# Autodesk Inventor assembly: montagem_omnicare
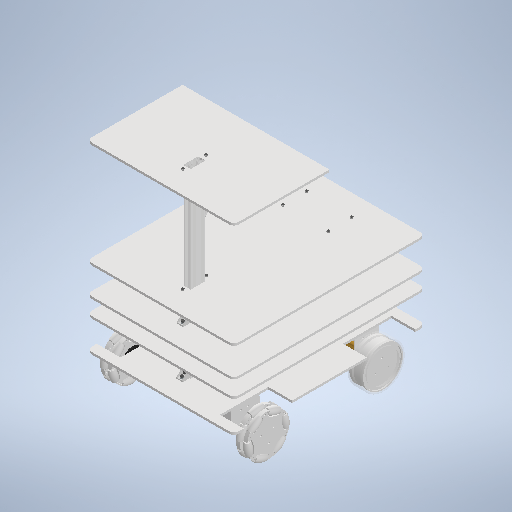
[picture p0: Inventor's stored thumbnail of the model, 512x512]
Saved by Autodesk Inventor 2025.2 (Build 292293000, 293)
## iProperties
Created: 2026-05-19
Part Number: montagem_omnicare
Document SubType Name: Assembly
Designer: joaoc
Author: joaoc
## iProperties of the stored document Chapa motor.ipt
Created: 2025-01-07
Part Number: Chapa motor
Material: Aluminum
Document SubType Name: Modeling
Designer: Cliente
Mass: 34.2734 g
Surface Area: 97.6448 cm^2
Volume: 12.6938 cm^3
Density: 2.7 g/cm^3
Appearance: Default
Sending System: Autodesk Inventor 2026
Author: Cliente
## iProperties of the stored document Perfil Estrutural em Alumínio 20x40 V-Slot - Canal 6 (180mm - 45º).ipt
Created: 2025-08-09
Part Number: Perfil Estrutural em Alumínio 20x40 V-Slot - Canal 6 (180mm - 45°)
Material: Aluminum 6061
Document SubType Name: Modeling
Designer: Cliente
Mass: 105 g
Surface Area: 421.207 cm^2
Volume: 41.3159 cm^3
Density: 2.5414 g/cm^3
Appearance: Default
Sending System: Autodesk Inventor 2026
Author: Cliente
## iProperties of the stored document Porca Sextavada DIN 934 - M4 - 8.ipt
Created: 2025-07-13
Part Number: Porca Sextavada DIN 934 - M4 - 8
Material: Stainless Steel
Document SubType Name: Modeling
Designer: Cliente
Mass: 0.824132 g
Surface Area: 1.70892 cm^2
Volume: 0.103016 cm^3
Density: 8 g/cm^3
Appearance: Default
Sending System: Autodesk Inventor 2026
Author: Cliente
## iProperties of the stored document Cantoneira em alumínio 20X20X17.ipt
Created: 2025-07-09
Part Number: Cantoneira em Alumínio 20X20X17
Material: Aluminum
Document SubType Name: Modeling
Designer: Cliente
Mass: 5.97516 g
Surface Area: 21.2782 cm^2
Volume: 2.21302 cm^3
Density: 2.7 g/cm^3
Appearance: Default
Sending System: Autodesk Inventor 2026
Author: Cliente
## iProperties of the stored document Parafuso Allen Cabeça Cilíndrica DIN 912 - M4 - 12.9_1.ipt
Created: 2025-07-13
Part Number: Parafuso Allen Cabeça Cilíndrica DIN 912 - M4 X 16 - 12.9
Material: Steel, Carbon
Document SubType Name: Modeling
Designer: Cliente
Mass: 2.27289 g
Surface Area: 4.7818 cm^2
Volume: 0.28954 cm^3
Density: 7.85 g/cm^3
Appearance: Default
Sending System: Autodesk Inventor 2026
Author: Cliente
## iProperties of the stored document Trava estrutura suporte manipulador - direita.ipt
Created: 2025-10-07
Part Number: Trava estrutura suporte manipulador - direita
Material: ABS Plastic
Document SubType Name: Modeling
Designer: Cliente
Mass: 28.5709 g
Surface Area: 125.242 cm^2
Volume: 26.9537 cm^3
Density: 1.06 g/cm^3
Appearance: Default
Sending System: Autodesk Inventor 2026
Author: Cliente
## iProperties of the stored document Cantoneira montada perfil x prateleira.iam
Created: 2025-07-09
Part Number: Cantoneira montada perfil x prateleira
Document SubType Name: Assembly
Designer: Cliente
Mass: 12.8728 g
Surface Area: 37.7866 cm^2
Volume: 3.08973 cm^3
Density: 4.16631 g/cm^3
Sending System: Autodesk Inventor 2026
Author: Cliente
## iProperties of the stored document Arruela de Pressão DIN 127 - B4.ipt
Created: 2025-07-13
Part Number: Arruela de Pressão DIN 127 - B4
Material: Steel, Carbon
Document SubType Name: Modeling
Designer: Cliente
Mass: 0.190332 g
Surface Area: 0.874611 cm^2
Volume: 0.0242461 cm^3
Density: 7.85 g/cm^3
Appearance: Default
Sending System: Autodesk Inventor 2026
Author: Cliente
## iProperties of the stored document Trava estrutura suporte manipulador - esquerda.ipt
Created: 2025-10-07
Part Number: Trava estrutura suporte manipulador - esquerda
Material: ABS Plastic
Document SubType Name: Modeling
Designer: Cliente
Mass: 28.5709 g
Surface Area: 125.242 cm^2
Volume: 26.9537 cm^3
Density: 1.06 g/cm^3
Appearance: Default
Sending System: Autodesk Inventor 2026
Author: Cliente
## iProperties of the stored document Calço motor Pittman.iam
Created: 2025-01-15
Part Number: Calço motor Pittman
Document SubType Name: Assembly
Designer: Cliente
Mass: 37.2182 g
Surface Area: 150.978 cm^2
Volume: 26.1282 cm^3
Density: 1.42444 g/cm^3
Sending System: Autodesk Inventor 2026
Author: Cliente
## iProperties of the stored document Perfil Estrutural em Alumínio 20x40 V-Slot - Canal 6 (210mm).ipt
Created: 2025-08-09
Part Number: Perfil Estrutural em Alumínio 20x40 V-Slot - Canal 6 (210mm)
Material: Aluminum 6061
Document SubType Name: Modeling
Designer: Cliente
Mass: 157.5 g
Surface Area: 625.192 cm^2
Volume: 61.9738 cm^3
Density: 2.5414 g/cm^3
Appearance: Default
Sending System: Autodesk Inventor 2026
Author: Cliente
## iProperties of the stored document Perfil Estrutural em Alumínio 20x40 V-Slot - Canal 6 (500mm).ipt
Created: 2025-08-09
Part Number: Perfil Estrutural em Alumínio 20x40 V-Slot - Canal 6 (500mm)
Material: Aluminum 6061
Document SubType Name: Modeling
Designer: Cliente
Mass: 375 g
Surface Area: 1480.4 cm^2
Volume: 147.557 cm^3
Density: 2.5414 g/cm^3
Appearance: Default
Sending System: Autodesk Inventor 2026
Author: Cliente
## iProperties of the stored document Calço motor Pittman.ipt
Created: 2025-01-07
Part Number: Calço motor Pittman
Material: ABS Plastic
Document SubType Name: Modeling
Designer: Cliente
Mass: 23.36 g
Surface Area: 117.987 cm^2
Volume: 24.3629 cm^3
Density: 1.06 g/cm^3
Appearance: Default
Sending System: Autodesk Inventor 2026
Author: Cliente
## iProperties of the stored document Parafuso Allen Cabeça Cilíndrica DIN 912 - M4 - 12.9.ipt
Created: 2025-07-13
Part Number: Parafuso Allen Cabeça Cilíndrica DIN 912 - M4 X 10 - 12.9
Material: Steel, Carbon
Document SubType Name: Modeling
Designer: Cliente
Mass: 1.80147 g
Surface Area: 3.65298 cm^2
Volume: 0.229486 cm^3
Density: 7.85 g/cm^3
Appearance: Default
Sending System: Autodesk Inventor 2026
Author: Cliente
## iProperties of the stored document Porca martelo M4 canal 6.ipt
Created: 2025-02-01
Part Number: Porca martelo M4 canal 6
Material: Steel, Galvanized
Document SubType Name: Modeling
Designer: Cliente
Mass: 1.0124 g
Surface Area: 2.07329 cm^2
Volume: 0.128969 cm^3
Density: 7.85 g/cm^3
Appearance: Default
Sending System: Autodesk Inventor 2026
Author: Cliente
## iProperties of the stored document Arruela Lisa DIN 125 - B4 - 300 HV.ipt
Created: 2025-07-13
Part Number: Arruela Lisa DIN 125 - B4 - 300 HV
Material: Steel, Carbon
Document SubType Name: Modeling
Designer: Cliente
Mass: 0.303016 g
Surface Area: 1.27111 cm^2
Volume: 0.0386007 cm^3
Density: 7.85 g/cm^3
Appearance: Default
Sending System: Autodesk Inventor 2026
Author: Cliente
## Documents named in this file (39)
- C:\Users\joaoc\Documents\montagem omnicare final\montagem_omnicare.iam
- C:\Users\joaoc\Documents\montagem omnicare final\chapeado MDF\base.ipt
- **C:\Users\joaoc\Documents\montagem omnicare final\montagem_omnicare.iam*LocalDocs*xAaaaqhbaAaaaaaaaAaaaa1vsCe*Perfil Estrutural em Alumínio 20x40 V-Slot - Canal 6 (500mm).ipt
- C:\Users\joaoc\Documents\montagem omnicare final\chapeado MDF\meio.ipt
- C:\Users\joaoc\Documents\montagem omnicare final\chapeado MDF\topo.ipt
- **C:\Users\joaoc\Documents\montagem omnicare final\montagem_omnicare.iam*LocalDocs*xAaaaazdaAaaaaaaaAaaaqctoEa*Perfil Estrutural em Alumínio 20x40 V-Slot - Canal 6 (210mm).ipt
- **C:\Users\joaoc\Documents\montagem omnicare final\montagem_omnicare.iam*LocalDocs*xAaaaahbaAaaaaaaaAaaaat5aXe*Cantoneira montada perfil x prateleira.iam
- C:\Users\joaoc\Documents\montagem omnicare final\Motor\Motor Pittman GM9413G937-R5.ipt
- **C:\Users\joaoc\Documents\montagem omnicare final\montagem_omnicare.iam*LocalDocs*xAaaaqdbaAaaaaaaaAaaaackpWc*Calço motor Pittman.iam
- **C:\Users\joaoc\Documents\montagem omnicare final\montagem_omnicare.iam*LocalDocs*xAaaaafaaAaaaaaaaAaaaae4iNe*Chapa motor.ipt
- C:\Users\joaoc\Documents\montagem omnicare final\Perfil de alumínio\Perfil de alumínio.ipt
- C:\Users\joaoc\Documents\montagem omnicare final\montagem roda omni (adaptada).iam
- **C:\Users\joaoc\Documents\montagem omnicare final\montagem_omnicare.iam*LocalDocs*xAaaaa2daAaaaaaaaAaaaaxveNg*Perfil Estrutural em Alumínio 20x40 V-Slot - Canal 6 (180mm - 45º).ipt
- **C:\Users\joaoc\Documents\montagem omnicare final\montagem_omnicare.iam*LocalDocs*xAaaaqibaAaaaaaaaAaaaqlyu4b*Trava estrutura suporte manipulador - esquerda.ipt
- **C:\Users\joaoc\Documents\montagem omnicare final\montagem_omnicare.iam*LocalDocs*xAaaaakdaAaaaaaaaAaaaqeo1Oa*Trava estrutura suporte manipulador - direita.ipt
- C:\Users\joaoc\Documents\montagem omnicare final\roda dif\roda diferencial.iam
- C:\Users\joaoc\Documents\montagem omnicare final\Fixação\Cantoneira montada perfil x prateleira.iam
- C:\Users\joaoc\Documents\montagem omnicare final\Fixação\Arruela de Pressão DIN 127 - B4.ipt
- C:\Users\joaoc\Documents\montagem omnicare final\Fixação\Arruela Lisa DIN 125 - B4 - 300 HV.ipt
- C:\Users\joaoc\Documents\montagem omnicare final\Fixação\Cantoneira em alumínio 20X20X17.ipt
- C:\Users\joaoc\Documents\montagem omnicare final\Fixação\Parafuso Allen Cabeça Cilíndrica DIN 912 - M4 - 12.9.ipt
- C:\Users\joaoc\Documents\montagem omnicare final\Fixação\Porca martelo M4 canal 6.ipt
- C:\Users\joaoc\Documents\montagem omnicare final\Fixação\Porca Sextavada DIN 934 - M4 - 8.ipt
- C:\Users\joaoc\Documents\montagem omnicare final\Perfil de alumínio\Perfil Estrutural em Alumínio 20x40 V-Slot - Canal 6 (500mm).ipt
- C:\Users\joaoc\Documents\montagem omnicare final\Perfil de alumínio\Perfil Estrutural em Alumínio 20x40 V-Slot - Canal 6 (210mm).ipt
- C:\Users\joaoc\Documents\montagem omnicare final\Motor\Calço motor Pittman.iam
- C:\Users\joaoc\Documents\montagem omnicare final\Impresso\Calço motor Pittman.ipt
- C:\Users\joaoc\Documents\montagem omnicare final\Motor\Chapa motor.ipt
- C:\Users\joaoc\Documents\montagem omnicare final\Perfil de alumínio\Perfil Estrutural em Alumínio 20x40 V-Slot - Canal 6 (180mm - 45º).ipt
- C:\Users\joaoc\Documents\montagem omnicare final\Impresso\Trava estrutura suporte manipulador - esquerda.ipt
- C:\Users\joaoc\Documents\montagem omnicare final\Impresso\Trava estrutura suporte manipulador - direita.ipt
- **C:\Users\joaoc\Documents\montagem omnicare final\montagem_omnicare.iam*LocalDocs*xAaaaa2aaAaaaaaaaAaaaq3xg0g*Porca Sextavada DIN 934 - M4 - 8.ipt
- **C:\Users\joaoc\Documents\montagem omnicare final\montagem_omnicare.iam*LocalDocs*xAaaaadaaAaaaaaaaAaaaqdxfMh*Cantoneira em alumínio 20X20X17.ipt
- **C:\Users\joaoc\Documents\montagem omnicare final\montagem_omnicare.iam*LocalDocs*xAaaaaxdaAaaaaaaaAaaaqaodOc*Parafuso Allen Cabeça Cilíndrica DIN 912 - M4 - 12.9_1.ipt
- **C:\Users\joaoc\Documents\montagem omnicare final\montagem_omnicare.iam*LocalDocs*xAaaaqxcaAaaaaaaaAaaaah4bBa*Arruela Lisa DIN 125 - B4 - 300 HV.ipt
- **C:\Users\joaoc\Documents\montagem omnicare final\montagem_omnicare.iam*LocalDocs*xAaaaaubaAaaaaaaaAaaaq04cSb*Arruela de Pressão DIN 127 - B4.ipt
- **C:\Users\joaoc\Documents\montagem omnicare final\montagem_omnicare.iam*LocalDocs*xAaaaqjcaAaaaaaaaAaaaawm1Eh*Parafuso Allen Cabeça Cilíndrica DIN 912 - M4 - 12.9.ipt
- **C:\Users\joaoc\Documents\montagem omnicare final\montagem_omnicare.iam*LocalDocs*xAaaaqwaaAaaaaaaaAaaaqfjfZh*Porca martelo M4 canal 6.ipt
- **C:\Users\joaoc\Documents\montagem omnicare final\montagem_omnicare.iam*LocalDocs*xAaaaqkbaAaaaaaaaAaaaqhjdWh*Calço motor Pittman.ipt
## Components (45 placed, 15 different names)
1. base:1 — Mate:25, Mate:33, Mate:35, Mate:46, Mate:47, Mate:49, Mate:50, Mate:54, Slider:8, Slider:9, Mate:73, Mate:74, Slider:11, Mate:108, Mate:109, Mate:110, Mate:111, Mate:112, Mate:162, Mate:163, Mate:164, Mate:165, Mate:166, Mate:167
2. Perfil Estrutural (500):1 — Slider:11, Mate:108, Mate:117, Mate:118, Mate:119, Mate:120, Mate:121, Mate:122, Mate:123, Mate:124, Mate:125, Mate:126, Mate:127, Mate:128, Mate:129, Mate:130, Mate:131, Mate:132, Slider:12, Mate:168, Mate:171, Mate:172, Mate:173, Mate:174, Mate:175, Mate:177
3. Perfil Estrutural (210mm):3 — Slider:8, Mate:73, Slider:10, Mate:75, Mate:78, Mate:79, Mate:80, Mate:81, Mate:88, Mate:89, Mate:90, Mate:91, Mate:92, Mate:93, Mate:94, Mate:95, Mate:100, Mate:101, Mate:102, Mate:103
4. Perfil Estrutural (210mm):4 — Slider:9, Mate:74, Mate:76, Mate:77, Mate:82, Mate:83, Mate:84, Mate:85, Mate:86, Mate:87, Mate:96, Mate:97, Mate:98, Mate:99, Mate:104, Mate:105, Mate:106, Mate:107
5. meio:1 — Mate:65, Mate:66, Mate:67, Mate:68, Mate:69, Mate:70, Mate:71, Mate:72, Slider:10, Mate:75, Mate:113, Mate:114, Mate:115, Mate:116
6. topo:1 — Slider:12, Mate:168, Mate:169, Mate:170, Mate:176, Mate:179, Mate:183
7. Perfil de alumínio:1 — Mate:149, Mate:150, Mate:151, Mate:152, Mate:155, Mate:156, Mate:157, Mate:160, Mate:161, Mate:163, Mate:164
8. montagem roda omni (adaptada):1 [sub-assembly] — Mate:165, Mate:166, Mate:167
9. roda diferencial:1 [sub-assembly] — Insert:1
10. roda diferencial:2 [sub-assembly] — Insert:2
11. Perfil Estrutural em Alumínio 20x40 V-Slot - Canal 6 (180mm - 45º):1 — Mate:175, Mate:176, Mate:177, Mate:178, Mate:182, Mate:184, Mate:185
12. Trava estrutura suporte manipulador - esquerda:1 — Mate:178, Mate:179, Mate:182
13. Trava estrutura suporte manipulador - direita:1 — Mate:183, Mate:184, Mate:185
14. Cantoneira montada perfil x prateleira:29 [sub-assembly] — Mate:170, Mate:171, Mate:173
15. Cantoneira montada perfil x prateleira:30 [sub-assembly] — Mate:169, Mate:172, Mate:174
16. Chapa motor:1 — Mate:140, Mate:141, Mate:142, Mate:152, Mate:156, Mate:157, Mate:160
17. Calço motor Pittman:1 [sub-assembly] — Mate:143, Mate:144, Mate:161
18. Motor Pittman GM9413G937-R5:1 — Mate:140, Mate:141, Mate:142, Mate:143, Mate:144, Insert:1
19. Motor Pittman GM9413G937-R5:2 — Mate:145, Mate:146, Mate:147, Mate:153, Mate:154, Insert:2
20. Calço motor Pittman:2 [sub-assembly] — Mate:153, Mate:154, Mate:155
21. Chapa motor:2 — Mate:145, Mate:146, Mate:147, Mate:149, Mate:150, Mate:151, Mate:162
22. Cantoneira montada perfil x prateleira:27 [sub-assembly] — Mate:110, Mate:118, Mate:126
23. Cantoneira montada perfil x prateleira:28 [sub-assembly] — Mate:109, Mate:117, Mate:125
24. Cantoneira montada perfil x prateleira:1 [sub-assembly] — Mate:54, Mate:90, Mate:91
25. Cantoneira montada perfil x prateleira:2 [sub-assembly] — Mate:25, Mate:86, Mate:87
26. Cantoneira montada perfil x prateleira:3 [sub-assembly] — Mate:33, Mate:84, Mate:85
27. Cantoneira montada perfil x prateleira:4 [sub-assembly] — Mate:35, Mate:88, Mate:89
28. Cantoneira montada perfil x prateleira:25 [sub-assembly] — Mate:112, Mate:121, Mate:127
29. Cantoneira montada perfil x prateleira:26 [sub-assembly] — Mate:111, Mate:122, Mate:128
30. Cantoneira montada perfil x prateleira:9 [sub-assembly] — Mate:50, Mate:78, Mate:79
31. Cantoneira montada perfil x prateleira:10 [sub-assembly] — Mate:47, Mate:82, Mate:83
32. Cantoneira montada perfil x prateleira:11 [sub-assembly] — Mate:46, Mate:80, Mate:81
33. Cantoneira montada perfil x prateleira:12 [sub-assembly] — Mate:49, Mate:76, Mate:77
34. Cantoneira montada perfil x prateleira:23 [sub-assembly] — Mate:114, Mate:120, Mate:131
35. Cantoneira montada perfil x prateleira:24 [sub-assembly] — Mate:113, Mate:119, Mate:129
36. Cantoneira montada perfil x prateleira:13 [sub-assembly] — Mate:65, Mate:92, Mate:93
37. Cantoneira montada perfil x prateleira:14 [sub-assembly] — Mate:67, Mate:94, Mate:95
38. Cantoneira montada perfil x prateleira:15 [sub-assembly] — Mate:66, Mate:97, Mate:98
39. Cantoneira montada perfil x prateleira:16 [sub-assembly] — Mate:68, Mate:96, Mate:99
40. Cantoneira montada perfil x prateleira:21 [sub-assembly] — Mate:116, Mate:123, Mate:130
41. Cantoneira montada perfil x prateleira:22 [sub-assembly] — Mate:115, Mate:124, Mate:132
42. Cantoneira montada perfil x prateleira:17 [sub-assembly] — Mate:69, Mate:104, Mate:105
43. Cantoneira montada perfil x prateleira:18 [sub-assembly] — Mate:70, Mate:102, Mate:103
44. Cantoneira montada perfil x prateleira:19 [sub-assembly] — Mate:72, Mate:106, Mate:107
45. Cantoneira montada perfil x prateleira:20 [sub-assembly] — Mate:71, Mate:100, Mate:101
## Relationships (124: Mate 117, TranslationJoint 5, Insert 2)
- Mate:25: base:1 ↔ Cantoneira montada perfil x prateleira:2
- Mate:33: base:1 ↔ Cantoneira montada perfil x prateleira:3
- Mate:35: base:1 ↔ Cantoneira montada perfil x prateleira:4
- Mate:46: base:1 ↔ Cantoneira montada perfil x prateleira:11
- Mate:47: base:1 ↔ Cantoneira montada perfil x prateleira:10
- Mate:49: base:1 ↔ Cantoneira montada perfil x prateleira:12
- Mate:50: base:1 ↔ Cantoneira montada perfil x prateleira:9
- Mate:54: base:1 ↔ Cantoneira montada perfil x prateleira:1
- Mate:65: meio:1 ↔ Cantoneira montada perfil x prateleira:13
- Mate:66: meio:1 ↔ Cantoneira montada perfil x prateleira:15
- Mate:67: meio:1 ↔ Cantoneira montada perfil x prateleira:14
- Mate:68: meio:1 ↔ Cantoneira montada perfil x prateleira:16
- Mate:69: meio:1 ↔ Cantoneira montada perfil x prateleira:17
- Mate:70: meio:1 ↔ Cantoneira montada perfil x prateleira:18
- Mate:71: meio:1 ↔ Cantoneira montada perfil x prateleira:20
- Mate:72: meio:1 ↔ Cantoneira montada perfil x prateleira:19
- Slider:8 [TranslationJoint]: base:1 ↔ Perfil Estrutural (210mm):3
- Slider:9 [TranslationJoint]: base:1 ↔ Perfil Estrutural (210mm):4
- Mate:73: base:1 ↔ Perfil Estrutural (210mm):3
- Mate:74: base:1 ↔ Perfil Estrutural (210mm):4
- Slider:10 [TranslationJoint]: Perfil Estrutural (210mm):3 ↔ meio:1
- Mate:75: Perfil Estrutural (210mm):3 ↔ meio:1
- Mate:76: Perfil Estrutural (210mm):4 ↔ Cantoneira montada perfil x prateleira:12
- Mate:77: Perfil Estrutural (210mm):4 ↔ Cantoneira montada perfil x prateleira:12
- Mate:78: Perfil Estrutural (210mm):3 ↔ Cantoneira montada perfil x prateleira:9
- Mate:79: Perfil Estrutural (210mm):3 ↔ Cantoneira montada perfil x prateleira:9
- Mate:80: Perfil Estrutural (210mm):3 ↔ Cantoneira montada perfil x prateleira:11
- Mate:81: Perfil Estrutural (210mm):3 ↔ Cantoneira montada perfil x prateleira:11
- Mate:82: Perfil Estrutural (210mm):4 ↔ Cantoneira montada perfil x prateleira:10
- Mate:83: Perfil Estrutural (210mm):4 ↔ Cantoneira montada perfil x prateleira:10
- Mate:84: Perfil Estrutural (210mm):4 ↔ Cantoneira montada perfil x prateleira:3
- Mate:85: Perfil Estrutural (210mm):4 ↔ Cantoneira montada perfil x prateleira:3
- Mate:86: Perfil Estrutural (210mm):4 ↔ Cantoneira montada perfil x prateleira:2
- Mate:87: Perfil Estrutural (210mm):4 ↔ Cantoneira montada perfil x prateleira:2
- Mate:88: Perfil Estrutural (210mm):3 ↔ Cantoneira montada perfil x prateleira:4
- Mate:89: Perfil Estrutural (210mm):3 ↔ Cantoneira montada perfil x prateleira:4
- Mate:90: Perfil Estrutural (210mm):3 ↔ Cantoneira montada perfil x prateleira:1
- Mate:91: Perfil Estrutural (210mm):3 ↔ Cantoneira montada perfil x prateleira:1
- Mate:92: Perfil Estrutural (210mm):3 ↔ Cantoneira montada perfil x prateleira:13
- Mate:93: Perfil Estrutural (210mm):3 ↔ Cantoneira montada perfil x prateleira:13
- Mate:94: Perfil Estrutural (210mm):3 ↔ Cantoneira montada perfil x prateleira:14
- Mate:95: Perfil Estrutural (210mm):3 ↔ Cantoneira montada perfil x prateleira:14
- Mate:96: Perfil Estrutural (210mm):4 ↔ Cantoneira montada perfil x prateleira:16
- Mate:97: Perfil Estrutural (210mm):4 ↔ Cantoneira montada perfil x prateleira:15
- Mate:98: Perfil Estrutural (210mm):4 ↔ Cantoneira montada perfil x prateleira:15
- Mate:99: Perfil Estrutural (210mm):4 ↔ Cantoneira montada perfil x prateleira:16
- Mate:100: Perfil Estrutural (210mm):3 ↔ Cantoneira montada perfil x prateleira:20
- Mate:101: Perfil Estrutural (210mm):3 ↔ Cantoneira montada perfil x prateleira:20
- Mate:102: Perfil Estrutural (210mm):3 ↔ Cantoneira montada perfil x prateleira:18
- Mate:103: Perfil Estrutural (210mm):3 ↔ Cantoneira montada perfil x prateleira:18
- Mate:104: Perfil Estrutural (210mm):4 ↔ Cantoneira montada perfil x prateleira:17
- Mate:105: Perfil Estrutural (210mm):4 ↔ Cantoneira montada perfil x prateleira:17
- Mate:106: Perfil Estrutural (210mm):4 ↔ Cantoneira montada perfil x prateleira:19
- Mate:107: Perfil Estrutural (210mm):4 ↔ Cantoneira montada perfil x prateleira:19
- Slider:11 [TranslationJoint]: base:1 ↔ Perfil Estrutural (500):1
- Mate:108: base:1 ↔ Perfil Estrutural (500):1
- Mate:109: base:1 ↔ Cantoneira montada perfil x prateleira:28
- Mate:110: base:1 ↔ Cantoneira montada perfil x prateleira:27
- Mate:111: base:1 ↔ Cantoneira montada perfil x prateleira:26
- Mate:112: base:1 ↔ Cantoneira montada perfil x prateleira:25
- Mate:113: meio:1 ↔ Cantoneira montada perfil x prateleira:24
- Mate:114: meio:1 ↔ Cantoneira montada perfil x prateleira:23
- Mate:115: meio:1 ↔ Cantoneira montada perfil x prateleira:22
- Mate:116: meio:1 ↔ Cantoneira montada perfil x prateleira:21
- Mate:117: Perfil Estrutural (500):1 ↔ Cantoneira montada perfil x prateleira:28
- Mate:118: Perfil Estrutural (500):1 ↔ Cantoneira montada perfil x prateleira:27
- Mate:119: Perfil Estrutural (500):1 ↔ Cantoneira montada perfil x prateleira:24
- Mate:120: Perfil Estrutural (500):1 ↔ Cantoneira montada perfil x prateleira:23
- Mate:121: Perfil Estrutural (500):1 ↔ Cantoneira montada perfil x prateleira:25
- Mate:122: Perfil Estrutural (500):1 ↔ Cantoneira montada perfil x prateleira:26
- Mate:123: Perfil Estrutural (500):1 ↔ Cantoneira montada perfil x prateleira:21
- Mate:124: Perfil Estrutural (500):1 ↔ Cantoneira montada perfil x prateleira:22
- Mate:125: Perfil Estrutural (500):1 ↔ Cantoneira montada perfil x prateleira:28
- Mate:126: Perfil Estrutural (500):1 ↔ Cantoneira montada perfil x prateleira:27
- Mate:127: Perfil Estrutural (500):1 ↔ Cantoneira montada perfil x prateleira:25
- Mate:128: Perfil Estrutural (500):1 ↔ Cantoneira montada perfil x prateleira:26
- Mate:129: Perfil Estrutural (500):1 ↔ Cantoneira montada perfil x prateleira:24
- Mate:130: Perfil Estrutural (500):1 ↔ Cantoneira montada perfil x prateleira:21
- Mate:131: Perfil Estrutural (500):1 ↔ Cantoneira montada perfil x prateleira:23
- Mate:132: Perfil Estrutural (500):1 ↔ Cantoneira montada perfil x prateleira:22
- Mate:140: Chapa motor:1 ↔ Motor Pittman GM9413G937-R5:1
- Mate:141: Chapa motor:1 ↔ Motor Pittman GM9413G937-R5:1
- Mate:142: Chapa motor:1 ↔ Motor Pittman GM9413G937-R5:1
- Mate:143: Calço motor Pittman:1 ↔ Motor Pittman GM9413G937-R5:1
- Mate:144 (5 mm): Calço motor Pittman:1 ↔ Motor Pittman GM9413G937-R5:1
- Mate:145: Motor Pittman GM9413G937-R5:2 ↔ Chapa motor:2
- Mate:146: Motor Pittman GM9413G937-R5:2 ↔ Chapa motor:2
- Mate:147: Motor Pittman GM9413G937-R5:2 ↔ Chapa motor:2
- Mate:149: Perfil de alumínio:1 ↔ Chapa motor:2
- Mate:150: Perfil de alumínio:1 ↔ Chapa motor:2
- Mate:151: Perfil de alumínio:1 ↔ Chapa motor:2
- Mate:152: Perfil de alumínio:1 ↔ Chapa motor:1
- Mate:153: Motor Pittman GM9413G937-R5:2 ↔ Calço motor Pittman:2
- Mate:154: Motor Pittman GM9413G937-R5:2 ↔ Calço motor Pittman:2
- Mate:155: Perfil de alumínio:1 ↔ Calço motor Pittman:2
- Mate:156: Perfil de alumínio:1 ↔ Chapa motor:1
- Mate:157: Perfil de alumínio:1 ↔ Chapa motor:1
- Mate:160: Perfil de alumínio:1 ↔ Chapa motor:1
- Mate:161: Perfil de alumínio:1 ↔ Calço motor Pittman:1
- Mate:162: base:1 ↔ Chapa motor:2
- Mate:163: base:1 ↔ Perfil de alumínio:1
- Mate:164: base:1 ↔ Perfil de alumínio:1
- Mate:165: base:1 ↔ montagem roda omni (adaptada):1
- Mate:166: base:1 ↔ montagem roda omni (adaptada):1
- Mate:167 (1 mm): base:1 ↔ montagem roda omni (adaptada):1
- Slider:12 [TranslationJoint]: Perfil Estrutural (500):1 ↔ topo:1
- Mate:168: Perfil Estrutural (500):1 ↔ topo:1
- Mate:169: topo:1 ↔ Cantoneira montada perfil x prateleira:30
- Mate:170: topo:1 ↔ Cantoneira montada perfil x prateleira:29
- Mate:171: Perfil Estrutural (500):1 ↔ Cantoneira montada perfil x prateleira:29
- Mate:172: Perfil Estrutural (500):1 ↔ Cantoneira montada perfil x prateleira:30
- Mate:173: Perfil Estrutural (500):1 ↔ Cantoneira montada perfil x prateleira:29
- Mate:174: Perfil Estrutural (500):1 ↔ Cantoneira montada perfil x prateleira:30
- Mate:175: Perfil Estrutural (500):1 ↔ Perfil Estrutural em Alumínio 20x40 V-Slot - Canal 6 (180mm - 45º):1
- Mate:176: topo:1 ↔ Perfil Estrutural em Alumínio 20x40 V-Slot - Canal 6 (180mm - 45º):1
- Mate:177 (1 mm): Perfil Estrutural (500):1 ↔ Perfil Estrutural em Alumínio 20x40 V-Slot - Canal 6 (180mm - 45º):1
- Mate:178: Perfil Estrutural em Alumínio 20x40 V-Slot - Canal 6 (180mm - 45º):1 ↔ Trava estrutura suporte manipulador - esquerda:1
- Mate:179: topo:1 ↔ Trava estrutura suporte manipulador - esquerda:1
- Mate:182 (1 mm): Perfil Estrutural em Alumínio 20x40 V-Slot - Canal 6 (180mm - 45º):1 ↔ Trava estrutura suporte manipulador - esquerda:1
- Mate:183: topo:1 ↔ Trava estrutura suporte manipulador - direita:1
- Mate:184: Perfil Estrutural em Alumínio 20x40 V-Slot - Canal 6 (180mm - 45º):1 ↔ Trava estrutura suporte manipulador - direita:1
- Mate:185: Perfil Estrutural em Alumínio 20x40 V-Slot - Canal 6 (180mm - 45º):1 ↔ Trava estrutura suporte manipulador - direita:1
- Insert:1: roda diferencial:1 ↔ Motor Pittman GM9413G937-R5:1
- Insert:2: roda diferencial:2 ↔ Motor Pittman GM9413G937-R5:2
